# Autodesk Inventor assembly: Ensamblaje1
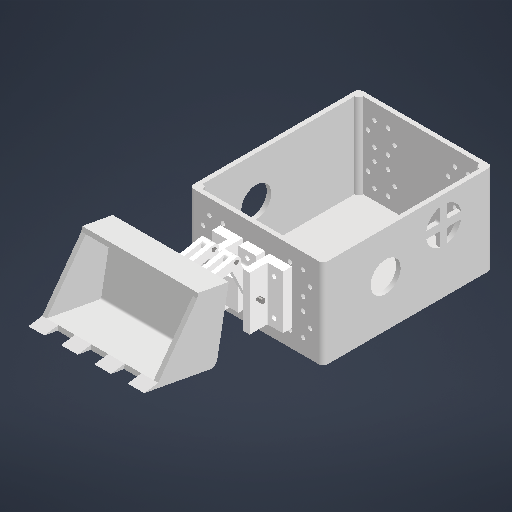
[picture p0: Inventor's stored thumbnail of the model, 512x512]
Saved by Autodesk Inventor 2027.1 (Build 311270010, 270A)
## iProperties
Created: 2026-10-01
Part Number: Ensamblaje1
Document SubType Name: Assembly
Designer: irene
Author: irene
## Documents named in this file (8)
- C:\Users\irene\Documents\Rover\V3\Pala\Ensamblaje1.iam
- C:\Users\irene\Documents\Rover\V3\Caja final.ipt
- C:\Users\irene\Documents\Rover\V3\Pala\Acople caja 1.ipt
- C:\Users\irene\Documents\Rover\V3\Pala\Acople caja 2.ipt
- C:\Users\irene\Documents\Rover\V3\Pala\Pieza1.ipt
- C:\Users\irene\Documents\Rover\V3\Pala\Ejess.ipt
- C:\Users\irene\Documents\Rover\V3\Pala\Ejesss.ipt
- C:\Users\irene\Documents\Rover\V3\Pala\Pala.ipt
## Components (15 placed, 7 different names)
1. Caja final:1 — Nivelación:1, Coincidencia:1, Nivelación:2, Cilíndrica:3, Cilíndrica:4, Coincidencia:3, Coincidencia:4, Coincidencia:5, Cilíndrica:5, Cilíndrica:6, Coincidencia:11
2. Acople caja 1:2 — Cilíndrica:3, Cilíndrica:4, Coincidencia:3, Coincidencia:25
3. Acople caja 2:1 — Coincidencia:4, Coincidencia:5, Nivelación:3, Coincidencia:13, Coincidencia:15, Coincidencia:26
4. Acople caja 1:3 — Cilíndrica:5, Cilíndrica:6, Coincidencia:11, Nivelación:3, Coincidencia:19, Coincidencia:32
5. Pieza1:4 — Coincidencia:17, Coincidencia:18, Coincidencia:20, Coincidencia:34, Nivelación:4
6. Pieza1:5 — Coincidencia:14, Coincidencia:16, Coincidencia:20, Coincidencia:28, Coincidencia:29
7. Pieza1:6 — Coincidencia:14, Coincidencia:15, Coincidencia:16, Coincidencia:17, Coincidencia:18, Coincidencia:19
8. Pieza1:7 — Coincidencia:21, Coincidencia:22, Coincidencia:23, Coincidencia:27, Coincidencia:28, Coincidencia:29
9. Pieza1:8 — Coincidencia:23, Coincidencia:24, Coincidencia:27, Coincidencia:30, Coincidencia:31, Coincidencia:35, Nivelación:5
10. Pieza1:9 — Coincidencia:21, Coincidencia:22, Coincidencia:24, Coincidencia:25, Coincidencia:26
11. Pala:1 — Coincidencia:30, Coincidencia:31, Coincidencia:33
12. Ejess:1 — Coincidencia:32
13. Ejess:2 — Coincidencia:33
14. Ejesss:1 — Coincidencia:34, Nivelación:4
15. Ejesss:2 — Coincidencia:35, Nivelación:5
## Relationships (37: Mate 28, Flush 5, CylindricalJoint 4)
- Nivelación:1 [Flush]: Caja final:1
- Coincidencia:1 [Mate]: Caja final:1
- Nivelación:2 [Flush]: Caja final:1
- Cilíndrica:3 [CylindricalJoint]: Caja final:1 ↔ Acople caja 1:2
- Cilíndrica:4 [CylindricalJoint]: Caja final:1 ↔ Acople caja 1:2
- Coincidencia:3 [Mate]: Caja final:1 ↔ Acople caja 1:2
- Coincidencia:4 [Mate]: Caja final:1 ↔ Acople caja 2:1
- Coincidencia:5 [Mate]: Caja final:1 ↔ Acople caja 2:1
- Cilíndrica:5 [CylindricalJoint]: Caja final:1 ↔ Acople caja 1:3
- Cilíndrica:6 [CylindricalJoint]: Caja final:1 ↔ Acople caja 1:3
- Coincidencia:11 [Mate]: Caja final:1 ↔ Acople caja 1:3
- Nivelación:3 [Flush]: Acople caja 2:1 ↔ Acople caja 1:3
- Coincidencia:13 [Mate]: Acople caja 2:1
- Coincidencia:14 [Mate]: Pieza1:5 ↔ Pieza1:6
- Coincidencia:15 [Mate]: Acople caja 2:1 ↔ Pieza1:6
- Coincidencia:16 [Mate]: Pieza1:5 ↔ Pieza1:6
- Coincidencia:17 [Mate]: Pieza1:4 ↔ Pieza1:6
- Coincidencia:18 [Mate]: Pieza1:4 ↔ Pieza1:6
- Coincidencia:19 [Mate]: Acople caja 1:3 ↔ Pieza1:6
- Coincidencia:20 [Mate]: Pieza1:4 ↔ Pieza1:5
- Coincidencia:21 [Mate]: Pieza1:7 ↔ Pieza1:9
- Coincidencia:22 [Mate]: Pieza1:7 ↔ Pieza1:9
- Coincidencia:23 [Mate]: Pieza1:7 ↔ Pieza1:8
- Coincidencia:24 [Mate]: Pieza1:8 ↔ Pieza1:9
- Coincidencia:25 [Mate]: Acople caja 1:2 ↔ Pieza1:9
- Coincidencia:26 [Mate]: Acople caja 2:1 ↔ Pieza1:9
- Coincidencia:27 [Mate]: Pieza1:7 ↔ Pieza1:8
- Coincidencia:28 [Mate]: Pieza1:5 ↔ Pieza1:7
- Coincidencia:29 [Mate]: Pieza1:5 ↔ Pieza1:7
- Coincidencia:30 [Mate]: Pieza1:8 ↔ Pala:1
- Coincidencia:31 [Mate]: Pieza1:8 ↔ Pala:1
- Coincidencia:32 [Mate]: Acople caja 1:3 ↔ Ejess:1
- Coincidencia:33 [Mate]: Pala:1 ↔ Ejess:2
- Coincidencia:34 [Mate]: Pieza1:4 ↔ Ejesss:1
- Nivelación:4 [Flush]: Pieza1:4 ↔ Ejesss:1
- Coincidencia:35 [Mate]: Pieza1:8 ↔ Ejesss:2
- Nivelación:5 [Flush]: Pieza1:8 ↔ Ejesss:2
